# Autodesk Inventor assembly: Assembly-Flange
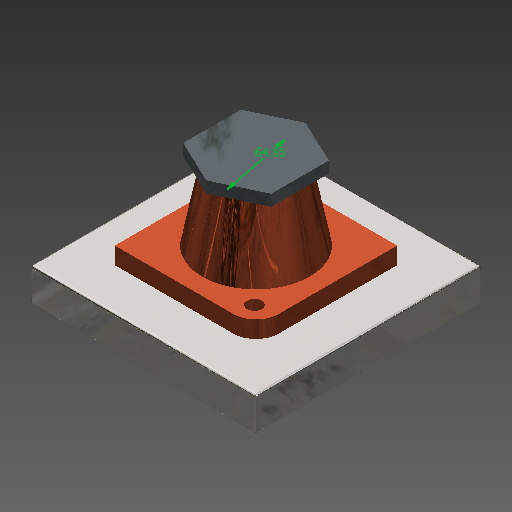
[picture p0: Inventor's stored thumbnail of the model, 512x512]
Saved by Autodesk Inventor 2026.1 (Build 301233020, 233B)
## iProperties
Created: 2026-10-26
Part Number: Assembly-Flange
Document SubType Name: Assembly
Designer: YmCris
Author: YmCris
## Documents named in this file (5)
- C:\Users\Fortune\Mechanical Engenieering\Fourth Semester\Mechanical Engineering Drawing\Inventor Projects\Classes\Assambling\Worksheet26-10-2026\Assembly-Flange.iam
- C:\Users\Fortune\Mechanical Engenieering\Fourth Semester\Mechanical Engineering Drawing\Inventor Projects\Classes\Assambling\Worksheet26-10-2026\Flange.ipt
- C:\Users\Fortune\Mechanical Engenieering\Fourth Semester\Mechanical Engineering Drawing\Inventor Projects\Classes\Assambling\Worksheet26-10-2026\P FLange.ipt
- C:\Users\Fortune\Mechanical Engenieering\Fourth Semester\Mechanical Engineering Drawing\Inventor Projects\Classes\Assambling\Worksheet26-10-2026\Tuerca.ipt
- C:\Users\Fortune\Mechanical Engenieering\Fourth Semester\Mechanical Engineering Drawing\Inventor Projects\Classes\Assambling\Worksheet26-10-2026\Bolt.ipt
## Components (4 placed, 4 different names)
1. Flange:1 — Mate:1, Mate:2, Mate:3
2. P FLange:1 — Mate:1, Mate:2, Insert:1
3. Tuerca:1 — Mate:3
4. Bolt:1 — Insert:1
## Relationships (4: Mate 3, Insert 1)
- Mate:1: Flange:1 ↔ P FLange:1
- Mate:2: Flange:1 ↔ P FLange:1
- Mate:3: Flange:1 ↔ Tuerca:1
- Insert:1: P FLange:1 ↔ Bolt:1
